# Autodesk Inventor assembly: robotfish_newest_1
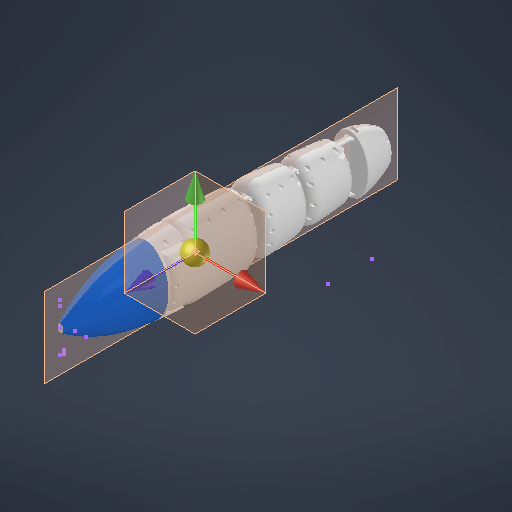
[picture p0: Inventor's stored thumbnail of the model, 512x512]
Saved by Autodesk Inventor 2027 (Build 310192060, 192F)
## iProperties
Created: 2026-09-06
Part Number: robotfish_newest_1
Document SubType Name: Assembly
Designer: thita
Mass: 4761.36 g
Surface Area: 6089.64 cm^2
Volume: 2720.04 cm^3
Density: 1.75047 g/cm^3
Sending System: Autodesk Inventor 2027
Preprocessor: ST-DEVELOPER v20.1
Title: robotfish_newest_1.stp
Author: Laptop
## Documents named in this file (23)
- D:\Year2\đồ án tốt nghịp\đồ án tốt nghiệp v2\mới nhất v15\robotfish_newest_1.iam
- D:\Year2\đồ án tốt nghịp\đồ án tốt nghiệp v2\mới nhất v15\FULL_FISH\Workgroups\NotInProject\thanh lk.ipt
- D:\Year2\đồ án tốt nghịp\đồ án tốt nghiệp v2\mới nhất v15\FULL_FISH\Workgroups\NotInProject\thanh lk 1.ipt
- D:\Year2\đồ án tốt nghịp\đồ án tốt nghiệp v2\mới nhất v15\FULL_FISH\Workgroups\NotInProject\manh_tren_truc_2.ipt
- D:\Year2\đồ án tốt nghịp\đồ án tốt nghiệp v2\mới nhất v15\FULL_FISH\Workgroups\NotInProject\manh_tren_truc_3.ipt
- D:\Year2\đồ án tốt nghịp\đồ án tốt nghiệp v2\mới nhất v15\FULL_FISH\Workgroups\NotInProject\hop v3.iam
- D:\Year2\đồ án tốt nghịp\đồ án tốt nghiệp v2\mới nhất v15\FULL_FISH\Workgroups\NotInProject\Assembly1.iam
- D:\Year2\đồ án tốt nghịp\đồ án tốt nghiệp v2\mới nhất v15\FULL_FISH\Workgroups\NotInProject\thanh lk 2.ipt
- D:\Year2\đồ án tốt nghịp\đồ án tốt nghiệp v2\mới nhất v15\FULL_FISH\Workgroups\NotInProject\thanh lk 4.ipt
- D:\Year2\đồ án tốt nghịp\đồ án tốt nghiệp v2\mới nhất v15\FULL_FISH\Workgroups\NotInProject\thanhlk 3.ipt
- D:\Year2\đồ án tốt nghịp\đồ án tốt nghiệp v2\mới nhất v15\FULL_FISH\Workgroups\NotInProject\thanhlk 5.ipt
- D:\Year2\đồ án tốt nghịp\đồ án tốt nghiệp v2\mới nhất v15\FULL_FISH\Workgroups\NotInProject\rigid_tailtail.ipt
- D:\Year2\đồ án tốt nghịp\đồ án tốt nghiệp v2\mới nhất v15\FULL_FISH\Workgroups\NotInProject\segment3.ipt
- D:\Year2\đồ án tốt nghịp\đồ án tốt nghiệp v2\mới nhất v15\FULL_FISH\Workgroups\NotInProject\truc_khop_3_MIR.ipt
- D:\Year2\đồ án tốt nghịp\đồ án tốt nghiệp v2\mới nhất v15\FULL_FISH\Workgroups\NotInProject\Pin 7.8Ah.ipt
- D:\Year2\đồ án tốt nghịp\đồ án tốt nghiệp v2\mới nhất v15\FULL_FISH\Workgroups\NotInProject\dau_robot.iam
- D:\Year2\đồ án tốt nghịp\đồ án tốt nghiệp v2\mới nhất v15\FULL_FISH\Workgroups\NotInProject\seg2_TRAI.ipt
- D:\Year2\đồ án tốt nghịp\đồ án tốt nghiệp v2\mới nhất v15\FULL_FISH\Workgroups\NotInProject\seg1_TRAI.ipt
- D:\Year2\đồ án tốt nghịp\đồ án tốt nghiệp v2\mới nhất v15\FULL_FISH\Workgroups\NotInProject\seg3_TRAI.ipt
- D:\Year2\đồ án tốt nghịp\đồ án tốt nghiệp v2\mới nhất v15\FULL_FISH\Workgroups\NotInProject\seg2_PHAI.ipt
- D:\Year2\đồ án tốt nghịp\đồ án tốt nghiệp v2\mới nhất v15\FULL_FISH\Workgroups\NotInProject\seg1_PHAI.ipt
- D:\Year2\đồ án tốt nghịp\đồ án tốt nghiệp v2\mới nhất v15\pcb.ipt
- D:\Year2\đồ án tốt nghịp\đồ án tốt nghiệp v2\mới nhất v15\ballast.ipt
## Components (23 placed, 22 different names)
1. thanh lk:1
2. thanh lk 1:1
3. manh_tren_truc_2:1
4. manh_tren_truc_3:1 — Rigid:1
5. hop v3:13 [sub-assembly]
6. hop v3:14 [sub-assembly]
7. Assembly1:17 [sub-assembly]
8. thanh lk 2:1
9. thanh lk 4:2
10. thanhlk 3:2
11. thanhlk 5:2
12. rigid_tailtail:3
13. segment3:4
14. truc_khop_3_MIR:2
15. Pin 7.8Ah:1
16. dau_robot:1 [sub-assembly] — Mate:1, Mate:2, Flush:1, Rigid:1
17. seg2_TRAI:1
18. seg1_TRAI:1
19. seg3_TRAI:1
20. seg2_PHAI:1
21. seg1_PHAI:1
22. pcb:1 — Mate:1, Flush:3
23. ballast:1 — Mate:2, Flush:2
## Relationships (6: Flush 3, Mate 2, WeldJoint 1)
- Mate:1 (15 mm): dau_robot:1 ↔ pcb:1
- Mate:2 (10 mm): dau_robot:1 ↔ ballast:1
- Flush:1: dau_robot:1
- Rigid:1 [WeldJoint]: manh_tren_truc_3:1 ↔ dau_robot:1
- Flush:2 (-15 mm): ballast:1
- Flush:3 (-5 mm): pcb:1
